# Autodesk Inventor assembly: ASM_grand_Robot_3
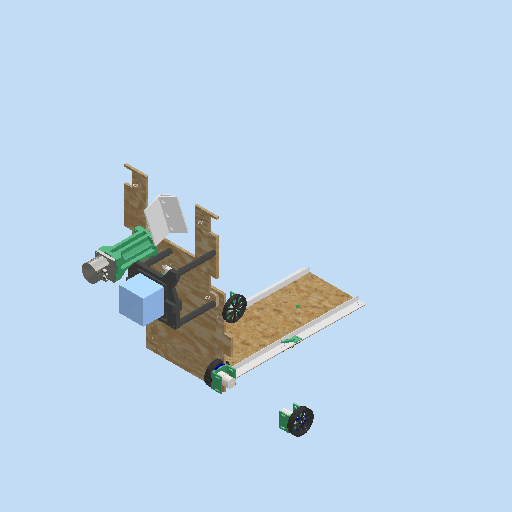
[picture p0: Inventor's stored thumbnail of the model, 512x512]
Saved by Autodesk Inventor 2026 (Build 300175050, 175E)
## iProperties
Created: 2025-05-15
Part Number: ASM_grand_Robot_3
Document SubType Name: Assembly
Designer: remg9
Author: remg9
## Documents named in this file (18)
- C:\Users\karle\OneDrive - HESSO\P2511_Dossier_partage_RVEZ\01_Robot\0101_CAO\ASM_grand_Robot_3.iam
- C:\Users\karle\OneDrive - HESSO\P2511_Dossier_partage_RVEZ\01_Robot\0101_CAO\0_Châssis\02_Grand Châssis\plateau_grand_robot_bas.ipt
- C:\Users\karle\OneDrive - HESSO\P2511_Dossier_partage_RVEZ\01_Robot\0101_CAO\Moteur\Support moteur double.ipt
- C:\Users\karle\OneDrive - HESSO\P2511_Dossier_partage_RVEZ\01_Robot\0101_CAO\0_Châssis\02_Grand Châssis\plateau_grand_robot.ipt
- C:\Users\karle\OneDrive - HESSO\P2511_Dossier_partage_RVEZ\01_Robot\0101_CAO\5_Pompe\5_2_supports_moteur_pompe.ipt
- C:\Users\karle\OneDrive - HESSO\P2511_Dossier_partage_RVEZ\01_Robot\0101_CAO\01_pont\1_pont.iam
- C:\Users\karle\OneDrive - HESSO\P2511_Dossier_partage_RVEZ\01_Robot\0101_CAO\Moteur\asm_moteur.iam
- C:\Users\karle\OneDrive - HESSO\P2511_Dossier_partage_RVEZ\01_Robot\0101_CAO\Moteur\adaptateur_axe_roulements.ipt
- C:\Users\karle\OneDrive - HESSO\P2511_Dossier_partage_RVEZ\01_Robot\0101_CAO\Moteur\asm_moteur_roue.iam
- C:\Users\karle\OneDrive - HESSO\P2511_Dossier_partage_RVEZ\01_Robot\0101_CAO\5_Pompe\5_1_pompe_model_1.1.ipt
- C:\Users\karle\OneDrive - HESSO\P2511_Dossier_partage_RVEZ\01_Robot\0101_CAO\Moteur\Adaptateur_Roulements_AxeRoues.ipt
- C:\Users\karle\OneDrive - HESSO\P2511_Dossier_partage_RVEZ\01_Robot\0101_CAO\Moteur\axe_4mm.ipt
- C:\Users\karle\OneDrive - HESSO\P2511_Dossier_partage_RVEZ\01_Robot\0101_CAO\Moteur\roues_3d_moteur_axe.ipt
- C:\Users\karle\OneDrive - HESSO\P2511_Dossier_partage_RVEZ\01_Robot\0101_CAO\01_pont\1_1_9_vis_cable.ipt
- C:\Users\karle\OneDrive - HESSO\P2511_Dossier_partage_RVEZ\01_Robot\0101_CAO\01_pont\1_1_10_1_directeur_de_cable.ipt
- C:\Users\karle\OneDrive - HESSO\P2511_Dossier_partage_RVEZ\01_Robot\0101_CAO\2_Stabil\Support_servomot.iam
- C:\Users\karle\OneDrive - HESSO\P2511_Dossier_partage_RVEZ\01_Robot\0101_CAO\0_Châssis\02_Grand Châssis\Support_arduino_grand_robot.ipt
- C:\Users\karle\OneDrive - HESSO\P2511_Dossier_partage_RVEZ\01_Robot\0101_CAO\2_Stabil\Stabi_2_1_vers2.iam
## Components (28 placed, 17 different names)
1. plateau_grand_robot_bas:1 — Passend:1, Passend:2, Fluchtend:4, Fluchtend:5, Fluchtend:7, Fluchtend:8, Passend:8, Fluchtend:9, Passend:9, Passend:11, Passend:13, Fluchtend:12, Einfügen:4, Einfügen:5, Passend:15, Fluchtend:13, Fluchtend:14, Passend:22
2. Support moteur double:1 — Passend:1, Fluchtend:1, Passend:5, Einfügen:12
3. Support moteur double:3 — Passend:2, Fluchtend:1, Passend:5, Fluchtend:4, Fluchtend:5, Fluchtend:11, Einfügen:7, Einfügen:14
4. plateau_grand_robot:1 — Fluchtend:7, Fluchtend:8, Passend:10, Passend:12, Passend:16, Einfügen:8, Einfügen:9, Passend:17, Passend:18, Passend:19, Passend:20, Tangential:1, Tangential:2, Tangential:3, Tangential:4, Tangential:5, Tangential:6, Tangential:7, Tangential:8, Passend:21, Einfügen:21, Winkel:1, Passend:22, Einfügen:22, Einfügen:23
5. 5_2_supports_moteur_pompe:1 — Einfügen:8, Einfügen:9, Einfügen:10, Einfügen:11
6. 1_pont:1 [sub-assembly] — Passend:8, Fluchtend:9, Passend:9, Einfügen:4, Einfügen:5
7. asm_moteur:1 [sub-assembly] — Passend:10, Passend:11, Fluchtend:10, Passend:14
8. asm_moteur:2 [sub-assembly] — Passend:12, Passend:13, Fluchtend:10, Passend:14, Fluchtend:11, Fluchtend:12
9. adaptateur_axe_roulements:1 — Einfügen:16
10. adaptateur_axe_roulements:2 — Einfügen:15, Einfügen:18
11. Support moteur double:4 — Passend:15, Einfügen:7, Einfügen:13
12. asm_moteur_roue:1 [sub-assembly] — Passend:16, Fluchtend:13, Fluchtend:14
13. 5_1_pompe_model_1.1:1 — Einfügen:10, Einfügen:11
14. Adaptateur_Roulements_AxeRoues:1 — Einfügen:12, Einfügen:16
15. Adaptateur_Roulements_AxeRoues:2 — Einfügen:14, Einfügen:15
16. Adaptateur_Roulements_AxeRoues:3 — Einfügen:13, Einfügen:17
17. adaptateur_axe_roulements:3 — Einfügen:17
18. axe_4mm:1 — Einfügen:18, Einfügen:19, Einfügen:20
19. roues_3d_moteur_axe:1 — Einfügen:19
20. roues_3d_moteur_axe:2 — Einfügen:20
21. 1_1_9_vis_cable:2 — Passend:17, Tangential:3, Tangential:4
22. 1_1_9_vis_cable:3 — Passend:20, Tangential:1, Tangential:2
23. 1_1_9_vis_cable:4 — Passend:19, Tangential:7, Tangential:8
24. 1_1_9_vis_cable:5 — Passend:18, Tangential:5, Tangential:6
25. 1_1_10_1_directeur_de_cable:1 — Passend:21, Einfügen:21, Winkel:1
26. Support_servomot:1 [sub-assembly]
27. Support_arduino_grand_robot:1
28. Stabi_2_1_vers2:1 [sub-assembly] — Einfügen:22, Einfügen:23
## Relationships (57: Insert 19, Mate 18, Flush 11, Tangent 8, Angle 1)
- Passend:1 [Mate]: plateau_grand_robot_bas:1 ↔ Support moteur double:1
- Passend:2 [Mate]: plateau_grand_robot_bas:1 ↔ Support moteur double:3
- Fluchtend:1 [Flush]: Support moteur double:1 ↔ Support moteur double:3
- Passend:5 [Mate] (-320 mm): Support moteur double:1 ↔ Support moteur double:3
- Fluchtend:4 [Flush] (30 mm): plateau_grand_robot_bas:1 ↔ Support moteur double:3
- Fluchtend:5 [Flush] (40 mm): plateau_grand_robot_bas:1 ↔ Support moteur double:3
- Fluchtend:7 [Flush]: plateau_grand_robot_bas:1 ↔ plateau_grand_robot:1
- Fluchtend:8 [Flush]: plateau_grand_robot_bas:1 ↔ plateau_grand_robot:1
- Passend:8 [Mate]: plateau_grand_robot_bas:1 ↔ 1_pont:1
- Fluchtend:9 [Flush] (60 mm): plateau_grand_robot_bas:1 ↔ 1_pont:1
- Passend:9 [Mate] (-40 mm): plateau_grand_robot_bas:1 ↔ 1_pont:1
- Passend:10 [Mate]: plateau_grand_robot:1 ↔ asm_moteur:1
- Passend:11 [Mate]: plateau_grand_robot_bas:1 ↔ asm_moteur:1
- Passend:12 [Mate]: plateau_grand_robot:1 ↔ asm_moteur:2
- Passend:13 [Mate]: plateau_grand_robot_bas:1 ↔ asm_moteur:2
- Fluchtend:10 [Flush]: asm_moteur:1 ↔ asm_moteur:2
- Passend:14 [Mate] (-320 mm): asm_moteur:1 ↔ asm_moteur:2
- Fluchtend:11 [Flush]: Support moteur double:3 ↔ asm_moteur:2
- Fluchtend:12 [Flush] (40 mm): plateau_grand_robot_bas:1 ↔ asm_moteur:2
- Einfügen:4 [Insert]: plateau_grand_robot_bas:1 ↔ 1_pont:1
- Einfügen:5 [Insert]: plateau_grand_robot_bas:1 ↔ 1_pont:1
- Passend:15 [Mate]: plateau_grand_robot_bas:1 ↔ Support moteur double:4
- Einfügen:7 [Insert] (-170 mm): Support moteur double:3 ↔ Support moteur double:4
- Passend:16 [Mate]: plateau_grand_robot:1 ↔ asm_moteur_roue:1
- Fluchtend:13 [Flush] (185 mm): plateau_grand_robot_bas:1 ↔ asm_moteur_roue:1
- Fluchtend:14 [Flush] (5 mm): plateau_grand_robot_bas:1 ↔ asm_moteur_roue:1
- Einfügen:8 [Insert]: plateau_grand_robot:1 ↔ 5_2_supports_moteur_pompe:1
- Einfügen:9 [Insert]: plateau_grand_robot:1 ↔ 5_2_supports_moteur_pompe:1
- Einfügen:10 [Insert]: 5_2_supports_moteur_pompe:1 ↔ 5_1_pompe_model_1.1:1
- Einfügen:11 [Insert]: 5_2_supports_moteur_pompe:1 ↔ 5_1_pompe_model_1.1:1
- Einfügen:12 [Insert]: Support moteur double:1 ↔ Adaptateur_Roulements_AxeRoues:1
- Einfügen:13 [Insert]: Support moteur double:4 ↔ Adaptateur_Roulements_AxeRoues:3
- Einfügen:14 [Insert]: Support moteur double:3 ↔ Adaptateur_Roulements_AxeRoues:2
- Einfügen:15 [Insert]: adaptateur_axe_roulements:2 ↔ Adaptateur_Roulements_AxeRoues:2
- Einfügen:16 [Insert]: adaptateur_axe_roulements:1 ↔ Adaptateur_Roulements_AxeRoues:1
- Einfügen:17 [Insert]: Adaptateur_Roulements_AxeRoues:3 ↔ adaptateur_axe_roulements:3
- Einfügen:18 [Insert] (-11 mm): adaptateur_axe_roulements:2 ↔ axe_4mm:1
- Einfügen:19 [Insert]: axe_4mm:1 ↔ roues_3d_moteur_axe:1
- Einfügen:20 [Insert]: axe_4mm:1 ↔ roues_3d_moteur_axe:2
- Passend:17 [Mate]: plateau_grand_robot:1 ↔ 1_1_9_vis_cable:2
- Passend:18 [Mate]: plateau_grand_robot:1 ↔ 1_1_9_vis_cable:5
- Passend:19 [Mate]: plateau_grand_robot:1 ↔ 1_1_9_vis_cable:4
- Passend:20 [Mate]: plateau_grand_robot:1 ↔ 1_1_9_vis_cable:3
- Tangential:1 (-42.5 mm): plateau_grand_robot:1 ↔ 1_1_9_vis_cable:3
- Tangential:2 (-27.5 mm): plateau_grand_robot:1 ↔ 1_1_9_vis_cable:3
- Tangential:3 (-42.5 mm): plateau_grand_robot:1 ↔ 1_1_9_vis_cable:2
- Tangential:4 (-27.5 mm): plateau_grand_robot:1 ↔ 1_1_9_vis_cable:2
- Tangential:5 (-27.5 mm): plateau_grand_robot:1 ↔ 1_1_9_vis_cable:5
- Tangential:6 (-27.5 mm): plateau_grand_robot:1 ↔ 1_1_9_vis_cable:5
- Tangential:7 (-27.5 mm): plateau_grand_robot:1 ↔ 1_1_9_vis_cable:4
- Tangential:8 (-27.5 mm): plateau_grand_robot:1 ↔ 1_1_9_vis_cable:4
- Passend:21 [Mate]: plateau_grand_robot:1 ↔ 1_1_10_1_directeur_de_cable:1
- Einfügen:21 [Insert]: plateau_grand_robot:1 ↔ 1_1_10_1_directeur_de_cable:1
- Winkel:1 [Angle] (0 deg): plateau_grand_robot:1 ↔ 1_1_10_1_directeur_de_cable:1
- Passend:22 [Mate]: plateau_grand_robot_bas:1 ↔ plateau_grand_robot:1
- Einfügen:22 [Insert]: plateau_grand_robot:1 ↔ Stabi_2_1_vers2:1
- Einfügen:23 [Insert]: plateau_grand_robot:1 ↔ Stabi_2_1_vers2:1
